# Autodesk Inventor assembly: MN0555AN200_G00_001
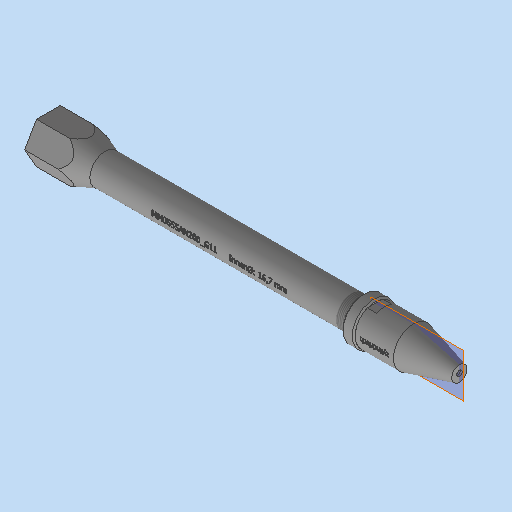
[picture p0: Inventor's stored thumbnail of the model, 512x512]
Saved by Autodesk Inventor 2023.3 (Build 273359000, 359)
## iProperties
RuleStatus: InUse
Created: 2022-11-09
Part Number: MN0555AN200_G00_001
Description: =<RBPARTNOTITLE2>
Document SubType Name: Assembly
Designer: ric7an
Mass: 325.298 g
Surface Area: 360.439 cm^2
Volume: 41.4393 cm^3
Density: 7.85 g/cm^3
AnP_Kategorie: 99
AnP_Material: =<Material>
AnP_TemplVers: 20200821
RBDOCUMENTTYPE: DRF
RBDOCUMENTVERSION: 00
RBDRAWINGMAINSCALE: 1:1
RBDRAWINGMISSINGSPEC: --
RBDRAWINGVOLUME: --
RBDSV1: 0850
RBGBEDGESIN1: +0,5
RBGBEDGESIN2: +0,2
RBGBEDGESOUT1: -0,3
RBGBEDGESOUT2: -0,1
RBMATERIAL: =<Material>
RBMATMEETS: --
RBMATNO: =<Part Number>
RBPARTMADEOF: --
RBPARTNO: SIEHE MNR
RBPARTNOTITLE1: support pipe cylindrical tip
RBPARTNOTITLE2: Stuetzhuelsen zylindrische Spitze
RBPARTSAFETYINDICATOR: --
RBSURFACE: --
RBSURFACE2: --
RBZEDGESNORM: ISO13715:2002-06
RBZGENDIMCLASS: m
RBZGENDIMNORM: ISO 2768-1:1989-11
RBZGENGEOCLASS: H
RBZGENGEONORM: ISO 2768-2:1989-11
RBZSURFACENORM: ISO13D2:2002-02
RBZTOLERANCENORM: ISO 14405-1:2010-12
Author: ric7an
Keywords: =<RBPARTMADEOF>
Comments: =<RBSURFACE2>
Revision Number: 01
## Documents named in this file (4)
- C:\Users\rea9an\Documents\Inventor\TCAI2412_te1910_EM\AS00000978.iam
- C:\Users\rea9an\Documents\Inventor\TCAI2412_te1910_EM\PT00004770.ipt
- C:\Users\rea9an\Documents\Inventor\TCAI2412_te1910_EM\PT00004771.ipt
- C:\Users\rea9an\Documents\Inventor\TCAI2412_te1910_EM\PT00004772.ipt
## Components (3 placed, 3 different names)
1. PT00004772:1 — Passend:1, Einfügen:4
2. PT00004770:1 — Passend:1, Einfügen:5
3. PT00004771:3 — Einfügen:4, Einfügen:5
## Relationships (3: Insert 2, Mate 1)
- Einfügen:4 [Insert] (10 mm): PT00004772:1 ↔ PT00004771:3
- Passend:1 [Mate]: PT00004772:1 ↔ PT00004770:1
- Einfügen:5 [Insert]: PT00004770:1 ↔ PT00004771:3
